# Autodesk Inventor assembly: Assembly1
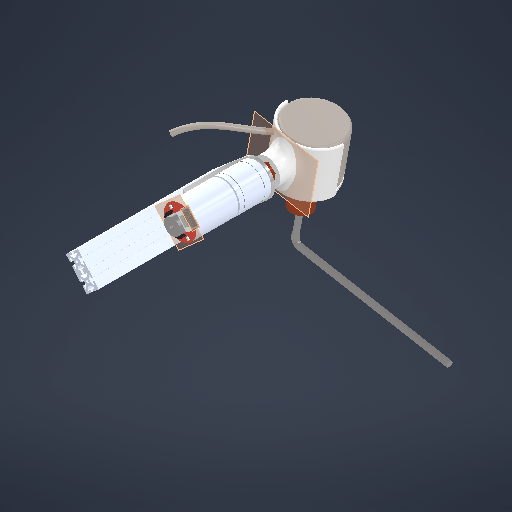
[picture p0: Inventor's stored thumbnail of the model, 512x512]
Saved by Autodesk Inventor 2026.2 (Build 302298000, 298)
## iProperties
Created: 2026-11-17
Part Number: Assembly1
Document SubType Name: Assembly
Designer: youse
Author: youse
## Documents named in this file (8)
- D:\modern control\Assembly1.iam
- D:\modern control\ROTERY ENCODER.step.ipt
- D:\modern control\Motor.ipt
- D:\modern control\Rigid 6 to 8mm Coupler v2.ipt
- D:\modern control\motor holder.ipt
- D:\modern control\ALLEN_04_mm.ipt
- D:\modern control\Assembly2\Assembly2.iam
- C:\Users\youse\Downloads\2020-aluminium-extrution-1.snapshot.1\80-20 Extrude aliminium\80-20 Extrude aliminium\80-20 Extrude aliminium.ipt
## Components (9 placed, 7 different names)
1. ROTERY ENCODER.step:1
2. Motor:1 — Mate:1, Mate:2, Mate:14, Mate:15
3. Rigid 6 to 8mm Coupler v2:1 — Mate:8, Mate:9, Mate:10, Mate:11, Mate:12
4. motor holder:1 — Mate:1, Mate:2, Mate:19, Flush:3, Flush:4
5. ALLEN_04_mm:1 — Mate:10, Mate:11
6. ROTERY ENCODER.step:2 — Mate:8, Mate:9, Mate:13
7. Assembly2:1 [sub-assembly] — Mate:12, Mate:13, Mate:14, Mate:15
8. 80-20 Extrude aliminium:1 — Flush:1, Mate:18, Flush:2, Flush:4
9. 80-20 Extrude aliminium:2 — Flush:1, Mate:18, Flush:2, Mate:19, Flush:3
## Relationships (16: Mate 12, Flush 4)
- Mate:1: Motor:1 ↔ motor holder:1
- Mate:2: Motor:1 ↔ motor holder:1
- Mate:8: Rigid 6 to 8mm Coupler v2:1 ↔ ROTERY ENCODER.step:2
- Mate:9: Rigid 6 to 8mm Coupler v2:1 ↔ ROTERY ENCODER.step:2
- Mate:10: Rigid 6 to 8mm Coupler v2:1 ↔ ALLEN_04_mm:1
- Mate:11: Rigid 6 to 8mm Coupler v2:1 ↔ ALLEN_04_mm:1
- Mate:12: Rigid 6 to 8mm Coupler v2:1 ↔ Assembly2:1
- Mate:13: ROTERY ENCODER.step:2 ↔ Assembly2:1
- Mate:14: Motor:1 ↔ Assembly2:1
- Mate:15: Motor:1 ↔ Assembly2:1
- Flush:1: 80-20 Extrude aliminium:1 ↔ 80-20 Extrude aliminium:2
- Mate:18: 80-20 Extrude aliminium:1 ↔ 80-20 Extrude aliminium:2
- Flush:2: 80-20 Extrude aliminium:1 ↔ 80-20 Extrude aliminium:2
- Mate:19: motor holder:1 ↔ 80-20 Extrude aliminium:2
- Flush:3: motor holder:1 ↔ 80-20 Extrude aliminium:2
- Flush:4: motor holder:1 ↔ 80-20 Extrude aliminium:1
